# Autodesk Inventor assembly: BOW DESIGN TWO PARTS
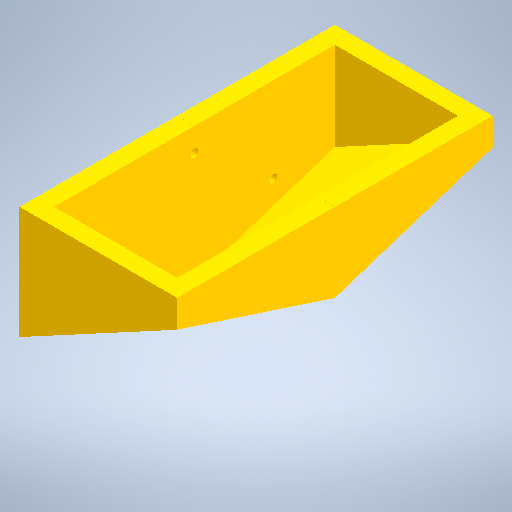
[picture p0: Inventor's stored thumbnail of the model, 512x512]
Saved by Autodesk Inventor 2026.2 (Build 302298000, 298)
## iProperties
Created: 2026-07-26
Part Number: BOW DESIGN TWO PARTS
Document SubType Name: Assembly
Designer: Taiye Raji
Author: Taiye Raji
## Documents named in this file (3)
- C:\Users\Taiye Raji\OneDrive - Stellenbosch University\Desktop\STELLENBOSCH UNIVERSITY MODULES\FOURTH YEAR MODULES\MECHATRONIC PROJECT\DRAWINGS\BOW DESIGN TWO PARTS.iam
- C:\Users\Taiye Raji\OneDrive - Stellenbosch University\Desktop\STELLENBOSCH UNIVERSITY MODULES\FOURTH YEAR MODULES\MECHATRONIC PROJECT\DRAWINGS\BOW DESIGN LEFT SIDE.ipt
- C:\Users\Taiye Raji\OneDrive - Stellenbosch University\Desktop\STELLENBOSCH UNIVERSITY MODULES\FOURTH YEAR MODULES\MECHATRONIC PROJECT\DRAWINGS\BOW DESIGN RIGHT SIDE.ipt
## Components (2 placed, 2 different names)
1. BOW DESIGN LEFT SIDE:1 — Mate:1, Mate:2, Flush:1, Flush:2
2. BOW DESIGN RIGHT SIDE:1 — Mate:1, Mate:2, Flush:1, Flush:2
## Relationships (4: Mate 2, Flush 2)
- Mate:1: BOW DESIGN LEFT SIDE:1 ↔ BOW DESIGN RIGHT SIDE:1
- Mate:2: BOW DESIGN LEFT SIDE:1 ↔ BOW DESIGN RIGHT SIDE:1
- Flush:1: BOW DESIGN LEFT SIDE:1 ↔ BOW DESIGN RIGHT SIDE:1
- Flush:2: BOW DESIGN LEFT SIDE:1 ↔ BOW DESIGN RIGHT SIDE:1
